# Autodesk Inventor assembly: MM0948AN140_G10_020
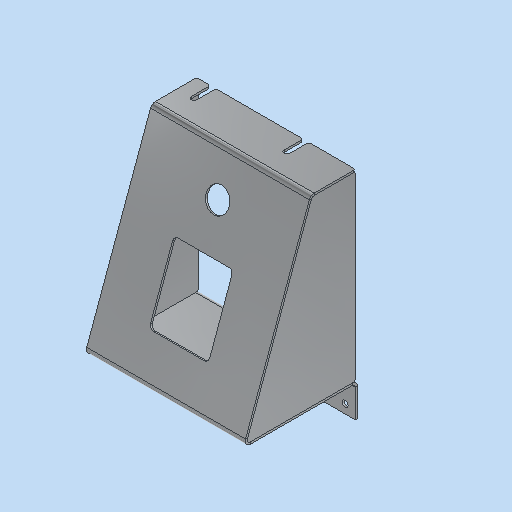
[picture p0: Inventor's stored thumbnail of the model, 512x512]
Saved by Autodesk Inventor 2023.3 (Build 273359000, 359)
## iProperties
Created: 2023-03-23
Part Number: MM0948AN140_G10_020
Description: =<RBPARTNOTITLE2>
Document SubType Name: Assembly
Designer: FH/Wi
Mass: 421.07 g
Surface Area: 1610.05 cm^2
Volume: 156.009 cm^3
Density: 2.699 g/cm^3
AnP_Kategorie: 99
AnP_Material: =<Material>
AnP_TemplVers: 20200821
RBDOCUMENTTYPE: DRF
RBDOCUMENTVERSION: 00
RBDRAWINGMAINSCALE: 1:1
RBDRAWINGMISSINGSPEC: --
RBDRAWINGVOLUME: --
RBDSV1: 0850
RBGBEDGESIN1: +0,5
RBGBEDGESIN2: +0,2
RBGBEDGESOUT1: -0,3
RBGBEDGESOUT2: -0,1
RBMATERIAL: =<Material>
RBMATMEETS: --
RBMATNO: =<Part Number>
RBPARTMADEOF: --
RBPARTNO: SIEHE MNR
RBPARTNOTITLE1: welded assembly
RBPARTNOTITLE2: Schweissbaugruppe
RBPARTSAFETYINDICATOR: --
RBSURFACE: anodised E6/EV1
RBSURFACE2: eloxiert E6/EV1 aluminiumfarbig
RBZEDGESNORM: ISO13715:2002-06
RBZGENDIMCLASS: m
RBZGENDIMNORM: ISO 2768-1:1989-11
RBZGENGEOCLASS: H
RBZGENGEONORM: ISO 2768-2:1989-11
RBZSURFACENORM: ISO13D2:2002-02
RBZTOLERANCENORM: ISO 14405-1:2010-12
Author: FH/Wi
Keywords: =<RBPARTMADEOF>
Comments: =<RBSURFACE2>
Revision Number: 01
## Documents named in this file (4)
- C:\Users\rea9an\Documents\Inventor\TCAI2412_te1910_EM\AS00000957.iam
- C:\Users\rea9an\Documents\Inventor\TCAI2412_te1910_EM\PT00004667.ipt
- C:\Users\rea9an\Documents\Inventor\TCAI2412_te1910_EM\PT00004670.ipt
- C:\Users\rea9an\Documents\Inventor\TCAI2412_te1910_EM\PT00004682.ipt
## Components (5 placed, 3 different names)
1. PT00004667:1
2. PT00004670:1
3. PT00004670:2
4. PT00004682:1
5. PT00004682:2
## Relationships (12: Mate 10, Flush 2)
- [Flush]: PT00004667:1 ↔ PT00004670:1
- [Mate]: PT00004667:1 ↔ PT00004670:1
- [Mate]: PT00004667:1 ↔ PT00004670:1
- [Mate]: PT00004667:1 ↔ PT00004682:1
- [Mate]: PT00004667:1 ↔ PT00004682:2
- [Mate] (114.5 mm): PT00004682:1 ↔ PT00004682:2
- [Mate] (-28.5 mm): PT00004667:1 ↔ PT00004682:1
- [Mate] (35.25 mm): PT00004667:1 ↔ PT00004682:1
- [Mate] (35.25 mm): PT00004667:1 ↔ PT00004682:2
- [Mate]: PT00004667:1 ↔ PT00004670:2
- [Mate]: PT00004667:1 ↔ PT00004670:2
- [Flush]: PT00004667:1 ↔ PT00004670:2
## Named parameters: d0_d7 = 0 mm, d1_d8 = 0 mm
